# Autodesk Inventor assembly: MM0868AN100_G80_507
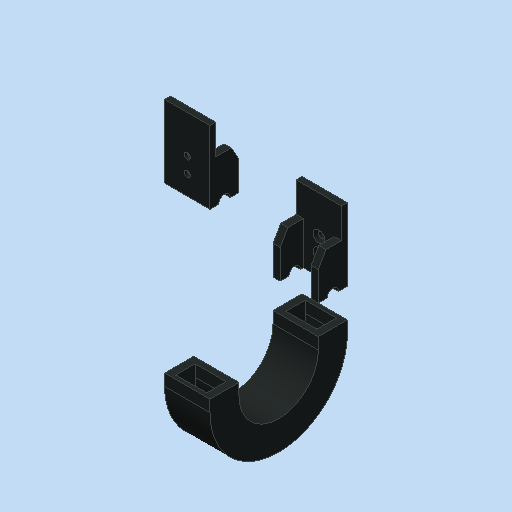
[picture p0: Inventor's stored thumbnail of the model, 512x512]
Saved by Autodesk Inventor 2023.3 (Build 273359000, 359)
## iProperties
Part Number: MM0868AN100_G80_507
Material: Generisch
Description: =<RBPARTNOTITLE2>
Document SubType Name: Assembly
Designer: Rose
Vendor: Igus
Mass: 27.4524 g
Surface Area: 198.64 cm^2
Volume: 27.4524 cm^3
Density: 1 g/cm^3
RBCHANGEDESCRIPTION1: Erstfreigabe
RBCHANGENO1: 00
RBDOCUMENTTYPE: DRF
RBDOCUMENTVERSION: 00
RBDRAWINGMAINSCALE: 1:1
RBDRAWINGMISSINGSPEC: --
RBDRAWINGVOLUME: --
RBDSV1: 0850
RBGBDETAILS: 43274
RBGBEDGESIN1: +0,5
RBGBEDGESIN2: +0,2
RBGBEDGESOUT1: -0,3
RBGBEDGESOUT2: -0,1
RBMATERIAL: =<Material>
RBMATMEETS: --
RBMATNO: =<Part Number>
RBORGUNITRESPONSIBLE1: AnP/TEF1
RBPARTMADEOF: E2C.10.16.028.0.ESD, 200mm + 2x E2.100.16.34PZ.ESD
RBPARTNO: SIEHE MNR
RBPARTNOTITLE1: energy chain 10 links
RBPARTNOTITLE2: Energiekette 10 Glieder
RBPARTSAFETYINDICATOR: --
RBSURFACE: --
RBSURFACE2: --
RBZEDGESNORM: ISO13715:2002-06
RBZGENDIMCLASS: m
RBZGENDIMNORM: ISO 2768-1:1989-11
RBZGENGEOCLASS: H
RBZGENGEONORM: ISO 2768-2:1989-11
RBZSURFACENORM: ISO13D2:2002-02
RBZTOLERANCENORM: ISO 14405-1:2010-12
AnP_Kommentar: --
MaxAbmaße: --
AnP_TemplVers: 20190222
AnP_Kategorie: 2
AnP_Material: =<Material>
Author: Rose
Keywords: =<RBPARTMADEOF>
Comments: =<RBSURFACE2>
Revision Number: 01
## Documents named in this file (3)
- C:\Users\rea9an\Documents\Inventor\TCAI2412_te1910_EM\AS00000902.iam
- C:\Users\rea9an\Documents\Inventor\TCAI2412_te1910_EM\PT00004503.ipt
- C:\Users\rea9an\Documents\Inventor\TCAI2412_te1910_EM\PT00004504.ipt
## Components (3 placed, 2 different names)
1. PT00004503:1 — Fluchtend:1, Fluchtend:2, Passend:1
2. PT00004503:2 — Fluchtend:3, Fluchtend:4, Passend:2
3. PT00004504:1 — Fluchtend:1, Fluchtend:2, Passend:1, Fluchtend:3, Fluchtend:4, Passend:2
## Relationships (6: Flush 4, Mate 2)
- Fluchtend:1 [Flush]: PT00004503:1 ↔ PT00004504:1
- Fluchtend:2 [Flush]: PT00004503:1 ↔ PT00004504:1
- Passend:1 [Mate] (85 mm): PT00004503:1 ↔ PT00004504:1
- Fluchtend:3 [Flush]: PT00004503:2 ↔ PT00004504:1
- Fluchtend:4 [Flush]: PT00004503:2 ↔ PT00004504:1
- Passend:2 [Mate] (15 mm): PT00004503:2 ↔ PT00004504:1
